# Autodesk Inventor assembly: 02_ASM_châssis_Proto
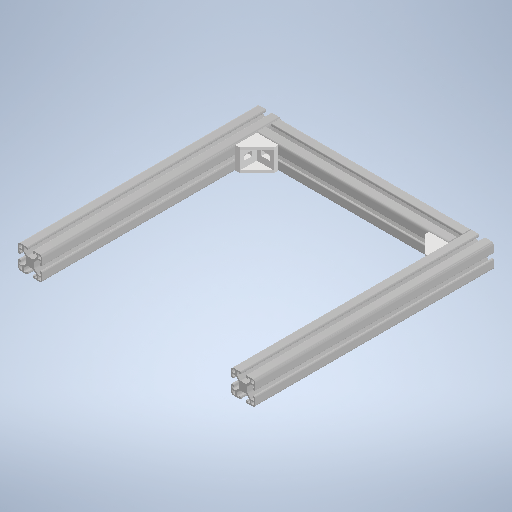
[picture p0: Inventor's stored thumbnail of the model, 512x512]
Saved by Autodesk Inventor 2025.3 (Build 293356000, 356)
## iProperties
Created: 2025-04-30
Part Number: 02_ASM_châssis_Proto
Document SubType Name: Assembly
Designer: AdminForWorker
Title: 02_ASM_châssis_Proto v1
Author: AdminForWorker
## Documents named in this file (4)
- C:\Users\karle\OneDrive - HESSO\P2511_Dossier_partage_RVEZ\01_Robot\0101_CAO\0_Châssis\02_Grand Châssis\02_ASM_châssis_Proto.iam
- C:\Users\karle\OneDrive - HESSO\P2511_Dossier_partage_RVEZ\01_Robot\0101_CAO\0_Châssis\02_Grand Châssis\02_3_Profilé_alu_30x30_300mm v1.iam
- C:\Users\karle\OneDrive - HESSO\P2511_Dossier_partage_RVEZ\01_Robot\0101_CAO\0_Châssis\02_Grand Châssis\02_2_profilé_alu_30x30_240mm v1.iam
- C:\Users\karle\OneDrive - HESSO\P2511_Dossier_partage_RVEZ\01_Robot\0101_CAO\0_Châssis\02_Grand Châssis\02_1_équerre_profilés v1.iam
## Components (8 placed, 3 different names)
1. 02_3_Profilé_alu_30x30_300mm v1:1 [sub-assembly] — Passend:4
2. 02_2_profilé_alu_30x30_240mm v1:1 [sub-assembly] — Passend:1, Passend:2, Passend:3, Passend:6
3. 02_3_Profilé_alu_30x30_300mm v1:2 [sub-assembly] — Passend:5
4. 02_2_profilé_alu_30x30_240mm v1:2 [sub-assembly] — Passend:1, Passend:2, Passend:3
5. 02_1_équerre_profilés v1:1 [sub-assembly] — Passend:4
6. 02_1_équerre_profilés v1:2 [sub-assembly] — Passend:5, Passend:6
7. 02_1_équerre_profilés v1:3 [sub-assembly]
8. 02_1_équerre_profilés v1:4 [sub-assembly]
## Relationships (6: Mate 6)
- Passend:1 [Mate] (100 mm): 02_2_profilé_alu_30x30_240mm v1:1 ↔ 02_2_profilé_alu_30x30_240mm v1:2
- Passend:2 [Mate] (100 mm): 02_2_profilé_alu_30x30_240mm v1:1 ↔ 02_2_profilé_alu_30x30_240mm v1:2
- Passend:3 [Mate]: 02_2_profilé_alu_30x30_240mm v1:1 ↔ 02_2_profilé_alu_30x30_240mm v1:2
- Passend:4 [Mate]: 02_3_Profilé_alu_30x30_300mm v1:1 ↔ 02_1_équerre_profilés v1:1
- Passend:5 [Mate]: 02_3_Profilé_alu_30x30_300mm v1:2 ↔ 02_1_équerre_profilés v1:2
- Passend:6 [Mate]: 02_2_profilé_alu_30x30_240mm v1:1 ↔ 02_1_équerre_profilés v1:2
